# Autodesk Inventor assembly: AssemblyMainAxis
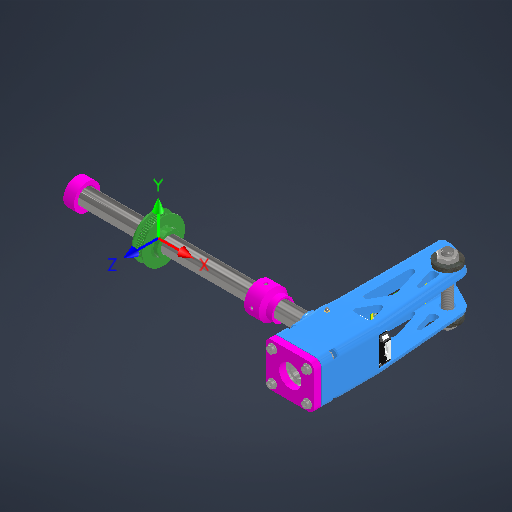
[picture p0: Inventor's stored thumbnail of the model, 512x512]
Saved by Autodesk Inventor 2027.1 (Build 311270010, 270A)
## iProperties
Created: 2026-10-15
Part Number: AssemblyMainAxis
Document SubType Name: Assembly
Designer: lucao
Mass: 430.148 g
Surface Area: 1328.14 cm^2
Volume: 291.789 cm^3
Density: 1.47418 g/cm^3
Author: lucao
## Documents named in this file (24)
- C:\Users\lucao\Desktop\RL-Rotary-Inverted-Double-Pendulum\CAD\AssemblyMainAxis.iam
- C:\Users\lucao\Desktop\RL-Rotary-Inverted-Double-Pendulum\CAD\encoder\AMT102-D2048-I6350-S\3D\AMT102-D2048-I6350-S\AMT102-D2048-I6350-S.ipt
- C:\Users\lucao\Desktop\RL-Rotary-Inverted-Double-Pendulum\CAD\drive_shaft_center.ipt
- C:\Users\lucao\Desktop\RL-Rotary-Inverted-Double-Pendulum\CAD\pulleyGT3_17mm.ipt
- C:\Users\lucao\Desktop\RL-Rotary-Inverted-Double-Pendulum\CAD\axialLock_mainShaft.ipt
- C:\Users\lucao\Documents\Inventor\Content Center Files\R2027\en-US\DIN 914\DIN 914 - M3 x 6.ipt
- C:\Users\lucao\Documents\Inventor\Content Center Files\R2027\en-US\DIN EN ISO 4036\DIN EN ISO 4036 - M3.ipt
- C:\Users\lucao\Desktop\RL-Rotary-Inverted-Double-Pendulum\CAD\link_mainaxis_to_horArm.ipt
- C:\Users\lucao\Documents\Inventor\Content Center Files\R2027\en-US\DIN BEARING(1)\DIN 625 SKF - SKF 6001.ipt
- C:\Users\lucao\Desktop\RL-Rotary-Inverted-Double-Pendulum\CAD\distanceTube_armshaft.ipt
- C:\Users\lucao\Desktop\RL-Rotary-Inverted-Double-Pendulum\CAD\slipRingMount_mainAxis.ipt
- C:\Users\lucao\Desktop\RL-Rotary-Inverted-Double-Pendulum\CAD\plate_arm_bearing_fix.ipt
- C:\Users\lucao\Documents\Inventor\Content Center Files\R2027\en-US\DIN EN ISO 7091\DIN EN ISO 7091 - 4.ipt
- C:\Users\lucao\Documents\Inventor\Content Center Files\R2027\en-US\DIN 6912\DIN 6912 - M4 x 25.ipt
- C:\Users\lucao\Desktop\RL-Rotary-Inverted-Double-Pendulum\CAD\Insert M3 D5 L5mm\Insert M3 D5 L5mm.ipt
- C:\Users\lucao\Documents\Inventor\Content Center Files\R2027\en-US\DIN 7984\DIN 7984 - M3 x 6.ipt
- C:\Users\lucao\Desktop\RL-Rotary-Inverted-Double-Pendulum\CAD\STM32 Mini F401\STM32MiniF401.iam
- C:\Users\lucao\Desktop\RL-Rotary-Inverted-Double-Pendulum\CAD\weight_rod.ipt
- C:\Users\lucao\Documents\Inventor\Content Center Files\R2027\en-US\ISO 4032(1)\ISO 4032 - M4DIN EN.ipt
- C:\Users\lucao\Desktop\RL-Rotary-Inverted-Double-Pendulum\CAD\slipRing.ipt
- C:\Users\lucao\Documents\Inventor\Content Center Files\R2027\en-US\DIN EN ISO 4027\DIN EN ISO 4027 - M3 x 16.ipt
- C:\Users\lucao\Desktop\RL-Rotary-Inverted-Double-Pendulum\CAD\Insert M3 D5 L5mm\Insert M3 D5 L5mm_MIR2.ipt
- C:\Users\lucao\Documents\Inventor\Content Center Files\R2027\en-US\DIN 7349\DIN 7349 - 10,5.ipt
- C:\Users\lucao\Documents\Inventor\Content Center Files\R2027\en-US\ISO 4035(1)\ISO 4035 - M10DIN EN.ipt
## Components (45 placed, 23 different names)
1. AMT102-D2048-I6350-S:1 — Mate:45
2. drive_shaft_center:1 — Mate:33, Mate:54, Mate:55
3. pulleyGT3_17mm:1 — Mate:53, Mate:56
4. axialLock_mainShaft:1 — Mate:52, Mate:56
5. link_mainaxis_to_horArm:1 — Mate:33, Mate:35, Mate:37, Mate:39, Mate:44, Mate:45, Mate:46, Mate:47, Mate:48, Mate:49, Mate:50, Mate:52, Flush:10
6. DIN 625 SKF SKF 6001:1
7. DIN 625 SKF SKF 6001:2
8. distanceTube_armshaft:1 — Mate:44
9. slipRingMount_mainAxis:1
10. plate_arm_bearing_fix:1
11. DIN EN ISO 7091 4:1
12. DIN EN ISO 7091 4:2
13. DIN EN ISO 7091 4:3
14. DIN EN ISO 7091 4:4
15. DIN 6912 M4 x 25:1
16. DIN 6912 M4 x 25:2 — Mate:34
17. DIN 6912 M4 x 25:3
18. DIN 6912 M4 x 25:4 — Mate:50
19. Insert M3 D5 L5mm:1
20. Insert M3 D5 L5mm:2
21. DIN 7984 M3 x 6:1
22. DIN 7984 M3 x 6:2
23. STM32MiniF401:1 [sub-assembly] — Flush:10
24. weight_rod:1 — Mate:36, Mate:38, Mate:40, Mate:42
25. DIN EN 24032 M4:1
26. DIN EN 24032 M4:2 — Mate:46, Mate:47
27. DIN EN 24032 M4:3 — Mate:34, Mate:35
28. DIN EN 24032 M4:4 — Mate:48, Mate:49
29. slipRing:1
30. Insert M3 D5 L5mm:3
31. DIN EN ISO 4027 M3 x 16:1
32. Insert M3 D5 L5mm_MIR2:1
33. DIN EN ISO 4027 M3 x 16:2
34. DIN 7349 10,5:1 — Mate:36, Mate:37, Mate:41
35. DIN 7349 10,5:2 — Mate:38, Mate:39, Mate:43
36. DIN EN 24035 M10:1 — Mate:40, Mate:41
37. DIN EN 24035 M10:2 — Mate:42, Mate:43
38. DIN 914 M3 x 6:1
39. DIN 914 M3 x 6:2
40. DIN 914 M3 x 6:3
41. DIN 914 M3 x 6:4
42. DIN EN ISO 4036 M3:1
43. DIN EN ISO 4036 M3:2
44. DIN EN ISO 4036 M3:3
45. DIN EN ISO 4036 M3:4
## Component patterns: (4 elements, first: DIN 914 M3 x 6:1), (4 elements, first: DIN EN ISO 4036 M3:1)
## Relationships (77: Mate 55, Flush 10, Insert 8, Angle 4)
- [Mate]: drive_shaft_center:1 ↔ pulleyGT3_17mm:1
- [Mate]: drive_shaft_center:1 ↔ axialLock_mainShaft:1
- [Mate]: axialLock_mainShaft:1 ↔ DIN 914 M3 x 6:1
- [Flush] (-14.5 mm): drive_shaft_center:1 ↔ DIN 914 M3 x 6:1
- [Mate]: DIN 914 M3 x 6:2 ↔ DIN EN ISO 4036 M3:1
- [Angle] (0 deg): axialLock_mainShaft:1 ↔ DIN EN ISO 4036 M3:1
- [Mate]: axialLock_mainShaft:1 ↔ DIN EN ISO 4036 M3:1
- [Mate]: drive_shaft_center:1 ↔ link_mainaxis_to_horArm:1
- [Mate]: link_mainaxis_to_horArm:1 ↔ DIN 625 SKF SKF 6001:1
- [Mate]: DIN 625 SKF SKF 6001:2 ↔ distanceTube_armshaft:1
- [Mate]: DIN 625 SKF SKF 6001:1 ↔ distanceTube_armshaft:1
- [Mate]: drive_shaft_center:1 ↔ slipRingMount_mainAxis:1
- [Mate]: drive_shaft_center:1 ↔ slipRingMount_mainAxis:1
- [Mate]: link_mainaxis_to_horArm:1 ↔ DIN 625 SKF SKF 6001:2
- [Mate]: link_mainaxis_to_horArm:1 ↔ DIN 625 SKF SKF 6001:1
- [Mate]: link_mainaxis_to_horArm:1 ↔ plate_arm_bearing_fix:1
- [Insert]: plate_arm_bearing_fix:1 ↔ DIN EN ISO 7091 4:1
- [Insert]: plate_arm_bearing_fix:1 ↔ DIN EN ISO 7091 4:2
- [Insert]: plate_arm_bearing_fix:1 ↔ DIN EN ISO 7091 4:3
- [Insert]: plate_arm_bearing_fix:1 ↔ DIN EN ISO 7091 4:4
- [Insert]: DIN EN ISO 7091 4:1 ↔ DIN 6912 M4 x 25:1
- [Insert]: DIN EN ISO 7091 4:2 ↔ DIN 6912 M4 x 25:2
- [Insert]: DIN EN ISO 7091 4:3 ↔ DIN 6912 M4 x 25:3
- [Insert]: DIN EN ISO 7091 4:4 ↔ DIN 6912 M4 x 25:4
- [Mate]: AMT102-D2048-I6350-S:1 ↔ link_mainaxis_to_horArm:1
- [Angle] (180 deg): AMT102-D2048-I6350-S:1 ↔ link_mainaxis_to_horArm:1
- [Mate]: link_mainaxis_to_horArm:1 ↔ Insert M3 D5 L5mm:1
- [Flush]: link_mainaxis_to_horArm:1 ↔ Insert M3 D5 L5mm:1
- [Mate]: link_mainaxis_to_horArm:1 ↔ Insert M3 D5 L5mm:2
- [Flush]: link_mainaxis_to_horArm:1 ↔ Insert M3 D5 L5mm:2
- [Mate]: link_mainaxis_to_horArm:1 ↔ DIN 7984 M3 x 6:1
- [Mate]: AMT102-D2048-I6350-S:1 ↔ DIN 7984 M3 x 6:1
- [Mate]: link_mainaxis_to_horArm:1 ↔ DIN 7984 M3 x 6:2
- [Mate]: AMT102-D2048-I6350-S:1 ↔ DIN 7984 M3 x 6:2
- [Mate]: DIN 625 SKF SKF 6001:2 ↔ plate_arm_bearing_fix:1
- [Angle] (0 deg): drive_shaft_center:1 ↔ link_mainaxis_to_horArm:1
- [Mate]: link_mainaxis_to_horArm:1 ↔ STM32MiniF401:1
- [Mate]: link_mainaxis_to_horArm:1 ↔ STM32MiniF401:1
- [Mate]: link_mainaxis_to_horArm:1 ↔ weight_rod:1
- [Flush] (-12.5 mm): link_mainaxis_to_horArm:1 ↔ weight_rod:1
- [Mate]: DIN 6912 M4 x 25:1 ↔ DIN EN 24032 M4:1
- [Mate]: link_mainaxis_to_horArm:1 ↔ DIN EN 24032 M4:1
- [Angle] (0 deg): link_mainaxis_to_horArm:1 ↔ DIN EN 24032 M4:1
- [Mate]: slipRingMount_mainAxis:1 ↔ slipRing:1
- [Flush]: slipRingMount_mainAxis:1 ↔ slipRing:1
- [Mate]: link_mainaxis_to_horArm:1 ↔ Insert M3 D5 L5mm:3
- [Flush]: link_mainaxis_to_horArm:1 ↔ Insert M3 D5 L5mm:3
- [Mate]: Insert M3 D5 L5mm:3 ↔ DIN EN ISO 4027 M3 x 16:1
- [Mate]: Insert M3 D5 L5mm_MIR2:1 ↔ DIN EN ISO 4027 M3 x 16:2
- [Mate]: link_mainaxis_to_horArm:1 ↔ Insert M3 D5 L5mm_MIR2:1
- [Flush]: link_mainaxis_to_horArm:1 ↔ Insert M3 D5 L5mm_MIR2:1
- [Flush] (-2 mm): link_mainaxis_to_horArm:1 ↔ DIN EN ISO 4027 M3 x 16:2
- [Flush] (-2 mm): link_mainaxis_to_horArm:1 ↔ DIN EN ISO 4027 M3 x 16:1
- Mate:33 (-25.5 mm): drive_shaft_center:1 ↔ link_mainaxis_to_horArm:1
- Mate:34: DIN 6912 M4 x 25:2 ↔ DIN EN 24032 M4:3
- Mate:35: link_mainaxis_to_horArm:1 ↔ DIN EN 24032 M4:3
- Mate:36: weight_rod:1 ↔ DIN 7349 10,5:1
- Mate:37: link_mainaxis_to_horArm:1 ↔ DIN 7349 10,5:1
- Mate:38: weight_rod:1 ↔ DIN 7349 10,5:2
- Mate:39: link_mainaxis_to_horArm:1 ↔ DIN 7349 10,5:2
- Mate:40: weight_rod:1 ↔ DIN EN 24035 M10:1
- Mate:41: DIN 7349 10,5:1 ↔ DIN EN 24035 M10:1
- Mate:42: weight_rod:1 ↔ DIN EN 24035 M10:2
- Mate:43: DIN 7349 10,5:2 ↔ DIN EN 24035 M10:2
- Mate:44: link_mainaxis_to_horArm:1 ↔ distanceTube_armshaft:1
- Mate:45: AMT102-D2048-I6350-S:1 ↔ link_mainaxis_to_horArm:1
- Mate:46: link_mainaxis_to_horArm:1 ↔ DIN EN 24032 M4:2
- Mate:47: link_mainaxis_to_horArm:1 ↔ DIN EN 24032 M4:2
- Mate:48: link_mainaxis_to_horArm:1 ↔ DIN EN 24032 M4:4
- Mate:49: link_mainaxis_to_horArm:1 ↔ DIN EN 24032 M4:4
- Mate:50: link_mainaxis_to_horArm:1 ↔ DIN 6912 M4 x 25:4
- Mate:52 (25.5 mm): axialLock_mainShaft:1 ↔ link_mainaxis_to_horArm:1
- Flush:10 (35 mm): link_mainaxis_to_horArm:1 ↔ STM32MiniF401:1
- Mate:53 (4 mm): pulleyGT3_17mm:1
- Mate:54: drive_shaft_center:1
- Mate:55: drive_shaft_center:1
- Mate:56 (92.1 mm): pulleyGT3_17mm:1 ↔ axialLock_mainShaft:1
